# Autodesk Inventor assembly: 2B_set
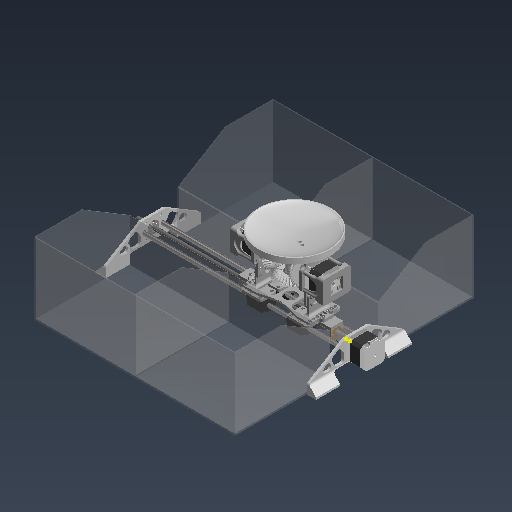
[picture p0: Inventor's stored thumbnail of the model, 512x512]
Saved by Autodesk Inventor 2026.2 (Build 302298010, 298A)
## iProperties
Created: 2026-03-18
Part Number: 2B_set
Document SubType Name: Assembly
Designer: work
Author: work
## Documents named in this file (35)
- C:\Users\khw\Desktop\ARD_v1\ARD_hardware\ARD_Model_v1\2B_set_rali.iam
- C:\Users\khw\Desktop\ARD_v1\ARD_hardware\ARD_Model_v1\1\A.ipt
- C:\Users\khw\Desktop\ARD_v1\ARD_hardware\ARD_Model_v1\C.ipt
- C:\Users\khw\Desktop\ARD_v1\ARD_hardware\ARD_Model_v1\Object\JIS B 1521 SKF (D) - SKF 608-Z.ipt
- C:\Users\khw\Desktop\ARD_v1\ARD_hardware\ARD_Model_v1\5_Co.ipt
- C:\Users\khw\Desktop\ARD_v1\ARD_hardware\ARD_Model_v1\NEMA17.ipt
- C:\Users\khw\Desktop\ARD_v1\ARD_hardware\ARD_Model_v1\1\B.ipt
- C:\Users\khw\Desktop\ARD_v1\ARD_hardware\ARD_Model_v1\R-1.ipt
- C:\Users\khw\Desktop\ARD_v1\ARD_hardware\ARD_Model_v1\R-2.ipt
- C:\Users\khw\Desktop\ARD_v1\ARD_hardware\ARD_Model_v1\Object\로드셀 센서.ipt
- C:\Users\khw\Desktop\ARD_v1\ARD_hardware\ARD_Model_v1\as5600_holder.ipt
- C:\Users\khw\Desktop\ARD_v1\ARD_hardware\ARD_Model_v1\hol.ipt
- C:\Users\khw\Desktop\ARD_v1\ARD_hardware\ARD_Model_v1\RALI1.ipt
- C:\Users\khw\Desktop\ARD_v1\ARD_hardware\ARD_Model_v1\magnet_as5600.ipt
- C:\Users\khw\Desktop\ARD_v1\ARD_hardware\ARD_Model_v1\Object\T8_LeadNut.ipt
- C:\Users\khw\Desktop\ARD_v1\ARD_hardware\ARD_Model_v1\Object\8T_Shaft.ipt
- C:\Users\khw\Desktop\ARD_v1\ARD_hardware\ARD_Model_v1\Object\T8_BellowsCoulping.ipt
- C:\Users\khw\Desktop\ARD_v1\ARD_hardware\ARD_Model_v1\Object\8T_ScrewShaft.ipt
- C:\Users\khw\Desktop\ARD_v1\ARD_hardware\ARD_Model_v1\Object\LeadWay.ipt
- C:\Users\khw\Desktop\ARD_v1\ARD_hardware\ARD_Model_v1\UR_rail_R_LinearWayCopler_v3.ipt
- C:\Users\khw\Desktop\ARD_v1\ARD_hardware\ARD_Model_v1\Object\KS B 1003 - M 3 x 20.ipt
- C:\Users\khw\Desktop\ARD_v1\ARD_hardware\ARD_Model_v1\KS B 1003 - M 3 x 10.ipt
- C:\Users\khw\Desktop\ARD_v1\ARD_hardware\ARD_Model_v1\Object\KS B 1003 - M 3 x 12.ipt
- C:\Users\khw\Desktop\ARD_v1\ARD_hardware\ARD_Model_v1\UR_rail_LeadNutHolder_v1.ipt
- C:\Users\khw\Desktop\ARD_v1\ARD_hardware\ARD_Model_v1\Object\KS B 1003 - M 3 x 16.ipt
- C:\Users\khw\Desktop\ARD_v1\ARD_hardware\ARD_Model_v1\stand.ipt
- C:\Users\khw\Desktop\ARD_v1\ARD_hardware\ARD_Model_v1\Object\box.ipt
- C:\Users\khw\Desktop\ARD_v1\ARD_hardware\ARD_Model_v1\2B_set\AIP\FEA\fdflh83ds.fins
- C:\Users\khw\Desktop\ARD_v1\ARD_hardware\ARD_Model_v1\2B_set\AIP\FEA\fdflh83ds.fsat
- C:\Users\khw\Desktop\ARD_v1\ARD_hardware\ARD_Model_v1\2B_set\AIP\FEA\fdflh83ds.ftes
- C:\Users\khw\Desktop\ARD_v1\ARD_hardware\ARD_Model_v1\2B_set\AIP\FEA\fdflh83ds.fwiz
- C:\Users\khw\Desktop\ARD_v1\ARD_hardware\ARD_Model_v1\2B_set_rali\AIP\FEA\fdjqx1t5s.fins
- C:\Users\khw\Desktop\ARD_v1\ARD_hardware\ARD_Model_v1\2B_set_rali\AIP\FEA\fdjqx1t5s.fsat
- C:\Users\khw\Desktop\ARD_v1\ARD_hardware\ARD_Model_v1\2B_set_rali\AIP\FEA\fdjqx1t5s.ftes
- C:\Users\khw\Desktop\ARD_v1\ARD_hardware\ARD_Model_v1\2B_set_rali\AIP\FEA\fdjqx1t5s.fwiz
## Components (93 placed, 26 different names)
1. box:1 — 플러쉬:10, 플러쉬:11, 플러쉬:12
2. box:2 — 메이트:117, 플러쉬:9, 플러쉬:11, 플러쉬:13
3. JIS B 1521 SKF (D) - SKF 608-Z:5 — 메이트:118, 플러쉬:14
4. stand:2 — 메이트:116, 플러쉬:8, 각도:12, 플러쉬:9, 플러쉬:10, 플러쉬:14
5. stand:1 — 메이트:114, 메이트:115, 각도:11, 메이트:117, 플러쉬:12, 플러쉬:13
6. UR_rail_R_LinearWayCopler_v3:1 — 메이트:68, 메이트:69, 메이트:70, 회전:1, 회전:2, 회전:3, 회전:4, 플러쉬:5, 메이트:79
7. UR_rail_R_LinearWayCopler_v3:2 — 플러쉬:5, 메이트:76, 메이트:77, 메이트:78
8. UR_rail_LeadNutHolder_v1:1 — 메이트:86, 메이트:87, 메이트:88, 메이트:89, 메이트:91, 메이트:92, 각도:9
9. UR_rail_LeadNutHolder_v1:2 — 메이트:95, 메이트:96, 메이트:97
10. UR_rail_R_LinearWayCopler_v3:4 — 메이트:106, 메이트:107, 메이트:108
11. UR_rail_R_LinearWayCopler_v3:3 — 메이트:109
12. as5600_holder:2 — 메이트:55, 메이트:56, 메이트:57
13. hol:2 — 메이트:53, 메이트:54, 각도:7, 메이트:56, 메이트:57, 메이트:61, 메이트:62, 메이트:63, 강체:3, 회전:37, 회전:38, 회전:39
14. hol:1 — 메이트:51, 각도:5, 메이트:52, 메이트:58, 메이트:59, 회전:40, 회전:41, 회전:42, 회전:43
15. RALI1:1 — 메이트:61, 메이트:62, 메이트:63, 메이트:76, 메이트:77, 메이트:78, 메이트:79, 회전:9, 회전:10, 회전:11, 회전:12, 메이트:80, 메이트:81, 메이트:82, 메이트:83, 메이트:89, 메이트:91, 메이트:92, 회전:16, 회전:17, 메이트:95, 메이트:96, 메이트:97, 회전:21, 회전:22, 메이트:106, 메이트:107, 메이트:108, 메이트:109, 회전:31, 회전:32, 회전:33, 회전:34, 회전:35, 회전:36
16. as5600_holder:1 — 메이트:58, 메이트:59, 메이트:60
17. B:2 — 회전:3
18. R-2:1 — 메이트:34, 메이트:35, 메이트:36, 메이트:38, 메이트:39, 메이트:47
19. R-1:1 — 메이트:40, 메이트:41, 메이트:42
20. A:1 — 메이트:1, 메이트:2, 메이트:11, 메이트:19, 메이트:22, 메이트:23, 회전:1, 각도:1
21. C:1 — 메이트:7, 메이트:8, 메이트:9, 메이트:10, 메이트:11, 메이트:27, 각도:4, 메이트:50, 플러쉬:3
22. A:2 — 메이트:10, 메이트:20, 메이트:21, 메이트:24, 회전:2
23. 5_Co:4 — 메이트:22, 메이트:23, 메이트:54
24. 5_Co:3 — 메이트:15, 플러쉬:1, 메이트:21, 메이트:24, 회전:3
25. B:1 — 메이트:25, 메이트:26, 메이트:27, 회전:1, 회전:2, 메이트:34, 메이트:35, 메이트:36
26. KS B 1003 - M 3 x 12:8 — 회전:20
27. KS B 1003 - M 3 x 12:9 — 회전:22
28. KS B 1003 - M 3 x 12:10 — 회전:21
29. KS B 1003 - M 3 x 12:5
30. KS B 1003 - M 3 x 12:6
31. KS B 1003 - M 3 x 12:7
32. KS B 1003 - M 3 x 16:1 — 회전:16
33. KS B 1003 - M 3 x 16:2 — 회전:17
34. KS B 1003 - M 3 x 20:6
35. KS B 1003 - M 3 x 20:7
36. KS B 1003 - M 3 x 20:8
37. KS B 1003 - M 3 x 20:9
38. KS B 1003 - M 3 x 10:1 — 회전:9
39. KS B 1003 - M 3 x 10:2 — 회전:11
40. KS B 1003 - M 3 x 10:3 — 회전:10
41. KS B 1003 - M 3 x 10:4 — 회전:12
42. KS B 1003 - M 3 x 10:5 — 메이트:81, 메이트:83
43. KS B 1003 - M 3 x 10:6 — 메이트:80, 메이트:82
44. KS B 1003 - M 3 x 12:1 — 회전:13
45. KS B 1003 - M 3 x 12:2 — 강체:1
46. KS B 1003 - M 3 x 12:3 — 회전:14, 메이트:86, 메이트:119
47. KS B 1003 - M 3 x 12:4 — 회전:15
48. KS B 1003 - M 3 x 20:1 — 회전:1
49. KS B 1003 - M 3 x 20:3 — 회전:3
50. KS B 1003 - M 3 x 20:4 — 회전:2
51. KS B 1003 - M 3 x 20:5 — 회전:4
52. JIS B 1521 SKF (D) - SKF 608-Z:4 — 메이트:50, 플러쉬:3
53. KS B 1003 - M 3 x 20:13
54. KS B 1003 - M 3 x 20:14
55. KS B 1003 - M 3 x 20:15
56. KS B 1003 - M 3 x 20:16
57. KS B 1003 - M 3 x 20:17
58. KS B 1003 - M 3 x 10:7 — 회전:31
59. KS B 1003 - M 3 x 10:8 — 회전:33
60. KS B 1003 - M 3 x 10:9 — 회전:32
61. KS B 1003 - M 3 x 10:10 — 회전:34
62. KS B 1003 - M 3 x 10:11 — 회전:36
63. KS B 1003 - M 3 x 10:12 — 회전:35
64. KS B 1003 - M 3 x 10:13 — 회전:38
65. KS B 1003 - M 3 x 10:14 — 회전:37
66. KS B 1003 - M 3 x 10:15 — 회전:39
67. KS B 1003 - M 3 x 10:16 — 강체:3
68. KS B 1003 - M 3 x 10:17 — 회전:41
69. KS B 1003 - M 3 x 10:18 — 회전:42
70. KS B 1003 - M 3 x 10:19 — 회전:43
71. KS B 1003 - M 3 x 10:20 — 회전:40
72. KS B 1003 - M 3 x 20:12
73. KS B 1003 - M 3 x 20:11
74. KS B 1003 - M 3 x 20:10
75. T8_LeadNut:2 — 회전:20
76. 8T_Shaft:2 — 플러쉬:7, 메이트:113, 플러쉬:8
77. LeadWay:3
78. LeadWay:4
79. NEMA17:3 — 메이트:110, 메이트:111, 각도:9, 각도:10, 메이트:113, 메이트:114, 메이트:115, 각도:11, 각도:12
80. LeadWay:2 — 메이트:75
81. T8_LeadNut:1 — 회전:13, 강체:1, 회전:14, 회전:15, 메이트:87, 메이트:88, 메이트:90, 회전/변환:1
82. 8T_Shaft:1 — 메이트:71, 메이트:75, 플러쉬:7
83. T8_BellowsCoulping:1 — 메이트:84, 메이트:85, 메이트:110, 메이트:111, 회전:4, 각도:10, 회전/변환:1, 메이트:119
84. 8T_ScrewShaft:1 — 메이트:84, 메이트:85, 메이트:90, 회전:4, 메이트:116, 메이트:118
85. LeadWay:1 — 메이트:68, 메이트:69, 메이트:70, 메이트:71
86. magnet_as5600:1 — 플러쉬:4
87. magnet_as5600:2 — 메이트:66, 메이트:67
88. JIS B 1521 SKF (D) - SKF 608-Z:2 — 메이트:8
89. JIS B 1521 SKF (D) - SKF 608-Z:3 — 메이트:7, 메이트:25, 메이트:26
90. JIS B 1521 SKF (D) - SKF 608-Z:1 — 메이트:1, 메이트:2, 메이트:9
91. NEMA17:1 — 메이트:15, 플러쉬:1, 메이트:20, 각도:4, 메이트:51, 각도:5, 각도:6, 메이트:52, 메이트:60, 메이트:66, 메이트:67
92. NEMA17:2 — 메이트:19, 각도:1, 각도:6, 메이트:53, 각도:7, 메이트:55, 플러쉬:4
93. 로드셀 센서:1 — 메이트:38, 메이트:39, 메이트:40, 메이트:41, 메이트:42, 메이트:47
## Relationships (172: Mate 98, RevoluteJoint 43, Flush 14, Angle 9, RelateRotation 4, WeldJoint 3, RelateRotateTranslate 1)
- 메이트:1 [Mate]: A:1 ↔ JIS B 1521 SKF (D) - SKF 608-Z:1
- 메이트:2 [Mate]: A:1 ↔ JIS B 1521 SKF (D) - SKF 608-Z:1
- [Mate]: A:2 ↔ JIS B 1521 SKF (D) - SKF 608-Z:2
- [Mate]: A:2 ↔ JIS B 1521 SKF (D) - SKF 608-Z:2
- 메이트:7 [Mate]: C:1 ↔ JIS B 1521 SKF (D) - SKF 608-Z:3
- 메이트:8 [Mate]: C:1 ↔ JIS B 1521 SKF (D) - SKF 608-Z:2
- 메이트:9 [Mate]: C:1 ↔ JIS B 1521 SKF (D) - SKF 608-Z:1
- 메이트:10 [Mate]: C:1 ↔ A:2
- 메이트:11 [Mate]: A:1 ↔ C:1
- 메이트:15 [Mate]: 5_Co:3 ↔ NEMA17:1
- 플러쉬:1 [Flush]: 5_Co:3 ↔ NEMA17:1
- [Mate]: 5_Co:4 ↔ NEMA17:2
- [Flush]: 5_Co:4 ↔ NEMA17:2
- 메이트:19 [Mate]: A:1 ↔ NEMA17:2
- 메이트:20 [Mate]: A:2 ↔ NEMA17:1
- 메이트:21 [Mate]: A:2 ↔ 5_Co:3
- 메이트:22 [Mate]: A:1 ↔ 5_Co:4
- 메이트:23 [Mate]: A:1 ↔ 5_Co:4
- 메이트:24 [Mate]: A:2 ↔ 5_Co:3
- 메이트:25 [Mate]: B:1 ↔ JIS B 1521 SKF (D) - SKF 608-Z:3
- 메이트:26 [Mate]: B:1 ↔ JIS B 1521 SKF (D) - SKF 608-Z:3
- 메이트:27 [Mate]: C:1 ↔ B:1
- 회전:1 [RelateRotation] (1 ul): A:1 ↔ B:1
- 회전:2 [RelateRotation] (1 ul): A:2 ↔ B:1
- 각도:1 [Angle] (720 deg): A:1 ↔ NEMA17:2
- 각도:4 [Angle] (180 deg): C:1 ↔ NEMA17:1
- 메이트:34 [Mate]: R-2:1 ↔ B:1
- 메이트:35 [Mate]: R-2:1 ↔ B:1
- 메이트:36 [Mate]: R-2:1 ↔ B:1
- 메이트:38 [Mate]: R-2:1 ↔ 로드셀 센서:1
- 메이트:39 [Mate]: R-2:1 ↔ 로드셀 센서:1
- 메이트:40 [Mate]: R-1:1 ↔ 로드셀 센서:1
- 메이트:41 [Mate]: R-1:1 ↔ 로드셀 센서:1
- 메이트:42 [Mate]: R-1:1 ↔ 로드셀 센서:1
- 메이트:47 [Mate]: R-2:1 ↔ 로드셀 센서:1
- [Mate]: B:2 ↔ JIS B 1521 SKF (D) - SKF 608-Z:4
- [Mate]: B:2 ↔ JIS B 1521 SKF (D) - SKF 608-Z:4
- 메이트:50 [Mate]: C:1 ↔ JIS B 1521 SKF (D) - SKF 608-Z:4
- 플러쉬:3 [Flush]: C:1 ↔ JIS B 1521 SKF (D) - SKF 608-Z:4
- 회전:3 [RelateRotation] (1 ul): B:2 ↔ 5_Co:3
- 메이트:51 [Mate]: hol:1 ↔ NEMA17:1
- 각도:5 [Angle] (0 deg): hol:1 ↔ NEMA17:1
- 각도:6 [Angle] (0 deg): NEMA17:1 ↔ NEMA17:2
- 메이트:52 [Mate]: hol:1 ↔ NEMA17:1
- 메이트:53 [Mate]: hol:2 ↔ NEMA17:2
- 메이트:54 [Mate]: hol:2 ↔ 5_Co:4
- 각도:7 [Angle] (0 deg): hol:2 ↔ NEMA17:2
- 메이트:55 [Mate] (1 mm): as5600_holder:2 ↔ NEMA17:2
- 메이트:56 [Mate]: as5600_holder:2 ↔ hol:2
- 메이트:57 [Mate]: as5600_holder:2 ↔ hol:2
- 메이트:58 [Mate]: hol:1 ↔ as5600_holder:1
- 메이트:59 [Mate]: hol:1 ↔ as5600_holder:1
- 메이트:60 [Mate] (1 mm): as5600_holder:1 ↔ NEMA17:1
- 메이트:61 [Mate]: hol:2 ↔ RALI1:1
- 메이트:62 [Mate]: hol:2 ↔ RALI1:1
- 메이트:63 [Mate]: hol:2 ↔ RALI1:1
- 플러쉬:4 [Flush]: magnet_as5600:1 ↔ NEMA17:2
- 메이트:66 [Mate]: magnet_as5600:2 ↔ NEMA17:1
- 메이트:67 [Mate]: magnet_as5600:2 ↔ NEMA17:1
- 메이트:68 [Mate]: UR_rail_R_LinearWayCopler_v3:1 ↔ LeadWay:1
- 메이트:69 [Mate]: UR_rail_R_LinearWayCopler_v3:1 ↔ LeadWay:1
- 메이트:70 [Mate]: UR_rail_R_LinearWayCopler_v3:1 ↔ LeadWay:1
- 메이트:71 [Mate]: 8T_Shaft:1 ↔ LeadWay:1
- 회전:1 [RevoluteJoint]: UR_rail_R_LinearWayCopler_v3:1 ↔ KS B 1003 - M 3 x 20:1
- 회전:2 [RevoluteJoint]: UR_rail_R_LinearWayCopler_v3:1 ↔ KS B 1003 - M 3 x 20:4
- 회전:3 [RevoluteJoint]: UR_rail_R_LinearWayCopler_v3:1 ↔ KS B 1003 - M 3 x 20:3
- 회전:4 [RevoluteJoint]: UR_rail_R_LinearWayCopler_v3:1 ↔ KS B 1003 - M 3 x 20:5
- [Mate]: UR_rail_R_LinearWayCopler_v3:2 ↔ LeadWay:2
- [Mate]: UR_rail_R_LinearWayCopler_v3:2 ↔ LeadWay:2
- [Mate]: UR_rail_R_LinearWayCopler_v3:2 ↔ LeadWay:2
- [RevoluteJoint]: UR_rail_R_LinearWayCopler_v3:2 ↔ KS B 1003 - M 3 x 20:6
- [RevoluteJoint]: UR_rail_R_LinearWayCopler_v3:2 ↔ KS B 1003 - M 3 x 20:8
- [RevoluteJoint]: UR_rail_R_LinearWayCopler_v3:2 ↔ KS B 1003 - M 3 x 20:7
- [RevoluteJoint]: UR_rail_R_LinearWayCopler_v3:2 ↔ KS B 1003 - M 3 x 20:9
- 메이트:75 [Mate]: LeadWay:2 ↔ 8T_Shaft:1
- 플러쉬:5 [Flush]: UR_rail_R_LinearWayCopler_v3:1 ↔ UR_rail_R_LinearWayCopler_v3:2
- 메이트:76 [Mate]: UR_rail_R_LinearWayCopler_v3:2 ↔ RALI1:1
- 메이트:77 [Mate]: UR_rail_R_LinearWayCopler_v3:2 ↔ RALI1:1
- 메이트:78 [Mate]: UR_rail_R_LinearWayCopler_v3:2 ↔ RALI1:1
- 메이트:79 [Mate]: UR_rail_R_LinearWayCopler_v3:1 ↔ RALI1:1
- 회전:9 [RevoluteJoint]: RALI1:1 ↔ KS B 1003 - M 3 x 10:1
- 회전:10 [RevoluteJoint]: RALI1:1 ↔ KS B 1003 - M 3 x 10:3
- 회전:11 [RevoluteJoint]: RALI1:1 ↔ KS B 1003 - M 3 x 10:2
- 회전:12 [RevoluteJoint]: RALI1:1 ↔ KS B 1003 - M 3 x 10:4
- 메이트:80 [Mate]: RALI1:1 ↔ KS B 1003 - M 3 x 10:6
- 메이트:81 [Mate]: RALI1:1 ↔ KS B 1003 - M 3 x 10:5
- 메이트:82 [Mate]: RALI1:1 ↔ KS B 1003 - M 3 x 10:6
- 메이트:83 [Mate]: RALI1:1 ↔ KS B 1003 - M 3 x 10:5
- 메이트:84 [Mate]: T8_BellowsCoulping:1 ↔ 8T_ScrewShaft:1
- 메이트:85 [Mate] (-10 mm): T8_BellowsCoulping:1 ↔ 8T_ScrewShaft:1
- 회전:13 [RevoluteJoint]: KS B 1003 - M 3 x 12:1 ↔ T8_LeadNut:1
- 강체:1 [WeldJoint]: KS B 1003 - M 3 x 12:2 ↔ T8_LeadNut:1
- 회전:14 [RevoluteJoint]: KS B 1003 - M 3 x 12:3 ↔ T8_LeadNut:1
- 회전:15 [RevoluteJoint]: KS B 1003 - M 3 x 12:4 ↔ T8_LeadNut:1
- 메이트:86 [Mate]: UR_rail_LeadNutHolder_v1:1 ↔ KS B 1003 - M 3 x 12:3
- 메이트:87 [Mate]: UR_rail_LeadNutHolder_v1:1 ↔ T8_LeadNut:1
- 메이트:88 [Mate]: UR_rail_LeadNutHolder_v1:1 ↔ T8_LeadNut:1
- 메이트:89 [Mate]: UR_rail_LeadNutHolder_v1:1 ↔ RALI1:1
- 메이트:90 [Mate]: T8_LeadNut:1 ↔ 8T_ScrewShaft:1
- 메이트:91 [Mate]: UR_rail_LeadNutHolder_v1:1 ↔ RALI1:1
- 메이트:92 [Mate]: UR_rail_LeadNutHolder_v1:1 ↔ RALI1:1
- 회전:16 [RevoluteJoint]: RALI1:1 ↔ KS B 1003 - M 3 x 16:1
- 회전:17 [RevoluteJoint]: RALI1:1 ↔ KS B 1003 - M 3 x 16:2
- [RevoluteJoint]: KS B 1003 - M 3 x 12:5 ↔ T8_LeadNut:2
- [WeldJoint]: KS B 1003 - M 3 x 12:6 ↔ T8_LeadNut:2
- [RevoluteJoint]: KS B 1003 - M 3 x 12:7 ↔ T8_LeadNut:2
- [Mate]: UR_rail_LeadNutHolder_v1:2 ↔ T8_LeadNut:2
- [Mate]: UR_rail_LeadNutHolder_v1:2 ↔ T8_LeadNut:2
- 메이트:95 [Mate]: UR_rail_LeadNutHolder_v1:2 ↔ RALI1:1
- 메이트:96 [Mate]: UR_rail_LeadNutHolder_v1:2 ↔ RALI1:1
- 메이트:97 [Mate]: UR_rail_LeadNutHolder_v1:2 ↔ RALI1:1
- 회전:20 [RevoluteJoint]: KS B 1003 - M 3 x 12:8 ↔ T8_LeadNut:2
- 회전:21 [RevoluteJoint]: RALI1:1 ↔ KS B 1003 - M 3 x 12:10
- 회전:22 [RevoluteJoint]: RALI1:1 ↔ KS B 1003 - M 3 x 12:9
- [Mate]: UR_rail_R_LinearWayCopler_v3:3 ↔ LeadWay:3
- [Mate]: UR_rail_R_LinearWayCopler_v3:3 ↔ LeadWay:3
- [Mate]: UR_rail_R_LinearWayCopler_v3:3 ↔ LeadWay:3
- [Mate]: 8T_Shaft:2 ↔ LeadWay:3
- [RevoluteJoint]: UR_rail_R_LinearWayCopler_v3:3 ↔ KS B 1003 - M 3 x 20:10
- [RevoluteJoint]: UR_rail_R_LinearWayCopler_v3:3 ↔ KS B 1003 - M 3 x 20:12
- [RevoluteJoint]: UR_rail_R_LinearWayCopler_v3:3 ↔ KS B 1003 - M 3 x 20:11
- [RevoluteJoint]: UR_rail_R_LinearWayCopler_v3:3 ↔ KS B 1003 - M 3 x 20:13
- [Mate]: UR_rail_R_LinearWayCopler_v3:4 ↔ LeadWay:4
- [Mate]: UR_rail_R_LinearWayCopler_v3:4 ↔ LeadWay:4
- [Mate]: UR_rail_R_LinearWayCopler_v3:4 ↔ LeadWay:4
- [RevoluteJoint]: UR_rail_R_LinearWayCopler_v3:4 ↔ KS B 1003 - M 3 x 20:14
- [RevoluteJoint]: UR_rail_R_LinearWayCopler_v3:4 ↔ KS B 1003 - M 3 x 20:16
- [RevoluteJoint]: UR_rail_R_LinearWayCopler_v3:4 ↔ KS B 1003 - M 3 x 20:15
- [RevoluteJoint]: UR_rail_R_LinearWayCopler_v3:4 ↔ KS B 1003 - M 3 x 20:17
- [Mate]: 8T_Shaft:2 ↔ LeadWay:4
- [Flush]: UR_rail_R_LinearWayCopler_v3:4 ↔ UR_rail_R_LinearWayCopler_v3:3
- 메이트:106 [Mate]: UR_rail_R_LinearWayCopler_v3:4 ↔ RALI1:1
- 메이트:107 [Mate]: UR_rail_R_LinearWayCopler_v3:4 ↔ RALI1:1
- 메이트:108 [Mate]: UR_rail_R_LinearWayCopler_v3:4 ↔ RALI1:1
- 메이트:109 [Mate]: UR_rail_R_LinearWayCopler_v3:3 ↔ RALI1:1
- 회전:31 [RevoluteJoint]: RALI1:1 ↔ KS B 1003 - M 3 x 10:7
- 회전:32 [RevoluteJoint]: RALI1:1 ↔ KS B 1003 - M 3 x 10:9
- 회전:33 [RevoluteJoint]: RALI1:1 ↔ KS B 1003 - M 3 x 10:8
- 회전:34 [RevoluteJoint]: RALI1:1 ↔ KS B 1003 - M 3 x 10:10
- 회전:35 [RevoluteJoint]: RALI1:1 ↔ KS B 1003 - M 3 x 10:12
- 회전:36 [RevoluteJoint]: RALI1:1 ↔ KS B 1003 - M 3 x 10:11
- 강체:3 [WeldJoint]: hol:2 ↔ KS B 1003 - M 3 x 10:16
- 회전:37 [RevoluteJoint]: hol:2 ↔ KS B 1003 - M 3 x 10:14
- 회전:38 [RevoluteJoint]: hol:2 ↔ KS B 1003 - M 3 x 10:13
- 회전:39 [RevoluteJoint]: hol:2 ↔ KS B 1003 - M 3 x 10:15
- 회전:40 [RevoluteJoint]: hol:1 ↔ KS B 1003 - M 3 x 10:20
- 회전:41 [RevoluteJoint]: hol:1 ↔ KS B 1003 - M 3 x 10:17
- 회전:42 [RevoluteJoint]: hol:1 ↔ KS B 1003 - M 3 x 10:18
- 회전:43 [RevoluteJoint]: hol:1 ↔ KS B 1003 - M 3 x 10:19
- 플러쉬:7 [Flush]: 8T_Shaft:2 ↔ 8T_Shaft:1
- 메이트:110 [Mate]: NEMA17:3 ↔ T8_BellowsCoulping:1
- 메이트:111 [Mate] (-10 mm): NEMA17:3 ↔ T8_BellowsCoulping:1
- 각도:9 [Angle] (0 deg): UR_rail_LeadNutHolder_v1:1 ↔ NEMA17:3
- 회전:4 [RelateRotation] (1 ul): T8_BellowsCoulping:1 ↔ 8T_ScrewShaft:1
- 각도:10 [Angle] (0 deg): NEMA17:3 ↔ T8_BellowsCoulping:1
- 회전/변환:1 [RelateRotateTranslate] (5 mm): T8_LeadNut:1 ↔ T8_BellowsCoulping:1
- 메이트:113 [Mate]: 8T_Shaft:2 ↔ NEMA17:3
- 메이트:114 [Mate]: stand:1 ↔ NEMA17:3
- 메이트:115 [Mate]: stand:1 ↔ NEMA17:3
- 각도:11 [Angle] (0 deg): stand:1 ↔ NEMA17:3
- 메이트:116 [Mate]: stand:2 ↔ 8T_ScrewShaft:1
- 플러쉬:8 [Flush]: stand:2 ↔ 8T_Shaft:2
- 각도:12 [Angle] (0 deg): stand:2 ↔ NEMA17:3
- 메이트:117 [Mate]: box:2 ↔ stand:1
- 플러쉬:9 [Flush]: box:2 ↔ stand:2
- 플러쉬:10 [Flush]: box:1 ↔ stand:2
- 플러쉬:11 [Flush]: box:1 ↔ box:2
- 플러쉬:12 [Flush]: box:1 ↔ stand:1
- 플러쉬:13 [Flush]: box:2 ↔ stand:1
- 메이트:118 [Mate]: JIS B 1521 SKF (D) - SKF 608-Z:5 ↔ 8T_ScrewShaft:1
- 플러쉬:14 [Flush]: JIS B 1521 SKF (D) - SKF 608-Z:5 ↔ stand:2
- 메이트:119 [Mate]: KS B 1003 - M 3 x 12:3 ↔ T8_BellowsCoulping:1
## Named parameters: d3_d1 = 0 mm, d4_d2 = 0 mm, d19_d15 = 0 mm, d20_d16 = 0 mm, sa_0 = 10000, d161_d108 = 0 mm, d162_d109 = 0 mm, d208_d196 = 0 mm, d209_d197 = 0 mm, d210_d198 = 0 mm, d211_d200 = 0 mm, d212_d201 = -3.86363 deg, d213_d202 = 0 mm, d214_d203 = -3.700189 deg, d215_d204 = 0 mm, d216_d205 = -92.009174 deg, d217_d206 = 0 mm, d218_d207 = -22.341835 deg, d267_d244 = 0 mm, d268_d245 = -13.723449 deg, d269_d246 = 0 mm, d270_d249 = 0 mm, d271_d250 = -13.773506 deg, d272_d253 = 0 mm, d273_d254 = 0 mm, d283_d196 = 0 mm, d284_d197 = 0 mm, d285_d198 = 0 mm, d286_d199 = 0 mm, d287_d200 = 0 mm, d288_d201 = 176.135816 deg, d289_d202 = 0 mm, d290_d203 = 176.300369 deg, d291_d204 = 0 mm, d292_d205 = -15.910263 deg, d293_d206 = 0 mm, d294_d207 = 157.658164 deg, d295_d208_d196 = 0 mm, d296_d209_d197 = 0 mm, d297_d210_d198 = 0 mm, d298_d211_d200 = 0 mm, d299_d212_d201 = -3.86363 deg, d300_d213_d202 = 0 mm, d301_d214_d203 = -3.700189 deg, d302_d215_d204 = 0 mm, d303_d216_d205 = -91.515348 deg, d304_d217_d206 = 0 mm, d305_d218_d207 = -22.341836 deg, d306_d219 = 0 mm, d307_d220 = 0 mm
note: some values were not read from the file. Shown as the stored number, unit unknown: "sa_0".
